# Autodesk Inventor assembly: MM0948AN150_G10_001
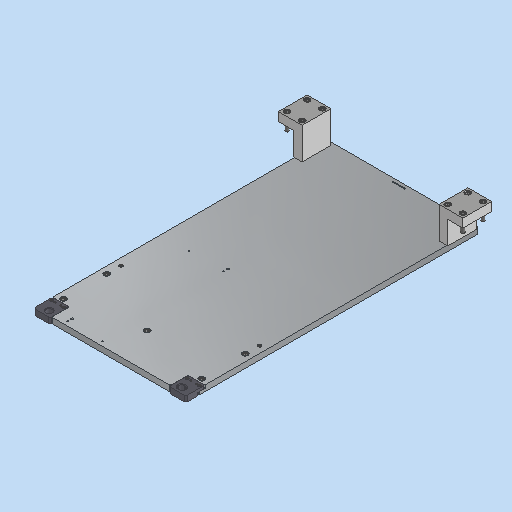
[picture p0: Inventor's stored thumbnail of the model, 512x512]
Saved by Autodesk Inventor 2023.3 (Build 273359000, 359)
## iProperties
RuleStatus: InUse
Created: 2023-03-23
Part Number: MM0948AN150_G10_001
Description: =<RBPARTNOTITLE2>
Document SubType Name: Assembly
Designer: FH/Wi
Mass: 19187.8 g
Surface Area: 13275.4 cm^2
Volume: 11610.3 cm^3
Density: 1.65265 g/cm^3
AnP_Kategorie: 99
AnP_Material: =<Material>
AnP_TemplVers: 20200821
RBDOCUMENTTYPE: DRF
RBDOCUMENTVERSION: 00
RBDRAWINGMAINSCALE: 1:1
RBDRAWINGMISSINGSPEC: --
RBDRAWINGVOLUME: --
RBDSV1: 0850
RBGBEDGESIN1: +0,5
RBGBEDGESIN2: +0,2
RBGBEDGESOUT1: -0,3
RBGBEDGESOUT2: -0,1
RBMATERIAL: =<Material>
RBMATMEETS: --
RBMATNO: =<Part Number>
RBPARTMADEOF: --
RBPARTNO: SIEHE MNR
RBPARTNOTITLE1: Cover plate_control cabinet
RBPARTNOTITLE2: Abdeckplatte_Schaltschrank
RBPARTSAFETYINDICATOR: --
RBSURFACE: --
RBSURFACE2: --
RBZEDGESNORM: ISO13715:2002-06
RBZGENDIMCLASS: m
RBZGENDIMNORM: ISO 2768-1:1989-11
RBZGENGEOCLASS: H
RBZGENGEONORM: ISO 2768-2:1989-11
RBZSURFACENORM: ISO13D2:2002-02
RBZTOLERANCENORM: ISO 14405-1:2010-12
Author: FH/Wi
Keywords: =<RBPARTMADEOF>
Comments: =<RBSURFACE2>
Revision Number: 01
## Documents named in this file (11)
- C:\Users\rea9an\Documents\Inventor\TCAI2412_te1910_EM\AS00000960.iam
- C:\Users\rea9an\Documents\Inventor\TCAI2412_te1910_EM\PT00004855.ipt
- C:\Users\rea9an\Documents\Inventor\TCAI2412_te1910_EM\PT00004852.ipt
- C:\Users\rea9an\Documents\Inventor\TCAI2412_te1910_EM\PT00004853.ipt
- C:\Users\rea9an\Documents\Inventor\TCAI2412_te1910_EM\PT00004898.ipt
- C:\Users\rea9an\Documents\Inventor\TCAI2412_te1910_EM\PT00004685.ipt
- C:\Users\rea9an\Documents\Inventor\TCAI2412_te1910_EM\PT00004686.ipt
- C:\Users\rea9an\Documents\Inventor\TCAI2412_te1910_EM\PT00004515.ipt
- C:\Users\rea9an\Documents\Inventor\TCAI2412_te1910_EM\PT00004926.ipt
- C:\Users\rea9an\Documents\Inventor\TCAI2412_te1910_EM\PT00004886.ipt
- C:\Users\rea9an\Documents\Inventor\TCAI2412_te1910_EM\PT00004516.ipt
## Components (28 placed, 10 different names)
1. PT00004685:1 — Passend:2, Passend:3, Passend:1, Einfügen:28, Passend:4, Einfügen:29, Passend:5
2. PT00004686:1
3. PT00004686:2
4. PT00004515:1 — Einfügen:29, Passend:5
5. PT00004926:1
6. PT00004926:2
7. PT00004886:1
8. PT00004886:2
9. PT00004516:1 — Einfügen:28, Passend:4
10. PT00004926:3
11. PT00004926:4
12. PT00004886:3
13. PT00004886:4
14. PT00004855:1
15. PT00004855:2
16. PT00004855:3
17. PT00004855:4
18. PT00004852:1
19. PT00004852:2
20. PT00004852:3
21. PT00004852:4
22. PT00004853:1
23. PT00004853:2
24. PT00004853:3
25. PT00004853:4
26. PT00004853:5
27. PT00004898:1
28. PT00004898:2
## Relationships (34: Insert 29, Mate 5)
- [Insert]: PT00004686:1 ↔ PT00004855:2
- [Insert]: PT00004686:1 ↔ PT00004855:1
- [Insert]: PT00004686:2 ↔ PT00004855:4
- [Insert]: PT00004686:2 ↔ PT00004855:3
- [Insert]: PT00004686:1 ↔ PT00004852:1
- [Insert]: PT00004686:1 ↔ PT00004852:2
- [Insert]: PT00004686:2 ↔ PT00004852:3
- [Insert]: PT00004686:2 ↔ PT00004852:4
- [Insert]: PT00004685:1 ↔ PT00004686:1
- [Insert]: PT00004685:1 ↔ PT00004686:1
- [Insert]: PT00004685:1 ↔ PT00004686:2
- [Insert]: PT00004685:1 ↔ PT00004686:2
- [Insert]: PT00004685:1 ↔ PT00004853:1
- [Insert]: PT00004685:1 ↔ PT00004853:2
- [Insert]: PT00004685:1 ↔ PT00004853:3
- [Insert]: PT00004685:1 ↔ PT00004853:5
- [Insert]: PT00004685:1 ↔ PT00004853:4
- [Insert]: PT00004685:1 ↔ PT00004898:2
- [Insert]: PT00004685:1 ↔ PT00004898:1
- Passend:2 [Mate]: PT00004685:1
- Passend:3 [Mate] (-5 mm): PT00004685:1
- Passend:1 [Mate] (1148 mm): PT00004685:1
- [Insert]: PT00004515:1 ↔ PT00004926:1
- [Insert]: PT00004515:1 ↔ PT00004926:2
- [Insert]: PT00004515:1 ↔ PT00004886:1
- [Insert]: PT00004515:1 ↔ PT00004886:2
- [Insert]: PT00004516:1 ↔ PT00004926:3
- [Insert]: PT00004516:1 ↔ PT00004926:4
- [Insert]: PT00004516:1 ↔ PT00004886:3
- [Insert]: PT00004516:1 ↔ PT00004886:4
- Einfügen:28 [Insert]: PT00004685:1 ↔ PT00004516:1
- Passend:4 [Mate]: PT00004685:1 ↔ PT00004516:1
- Einfügen:29 [Insert]: PT00004685:1 ↔ PT00004515:1
- Passend:5 [Mate]: PT00004685:1 ↔ PT00004515:1
## Named parameters: d260_d31 = 0 mm, d261_d32 = 0 mm, d28_d19 = 0 mm, d29_d20 = 0 mm
